# Autodesk Inventor assembly: MM0861AN100_G21_804
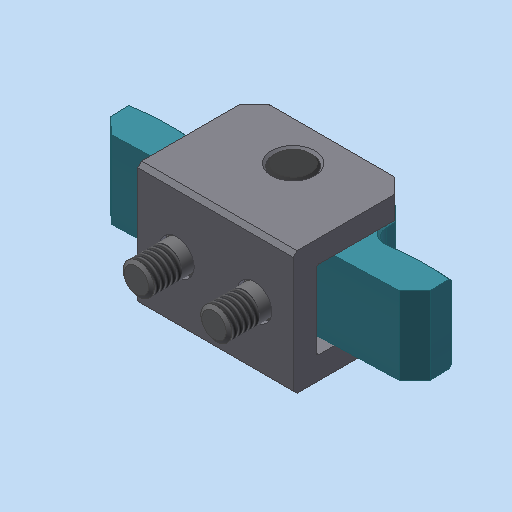
[picture p0: Inventor's stored thumbnail of the model, 512x512]
Saved by Autodesk Inventor 2023.3 (Build 273359000, 359)
## iProperties
Created: 2018-10-31
Part Number: MM0861AN100_G21_804
Document SubType Name: Assembly
Designer: Rose
Mass: 40.103 g
Surface Area: 44.0912 cm^2
Volume: 5.10866 cm^3
Density: 7.85 g/cm^3
AnP_Kommentar_aktuell: =<Comments>
AnP_Material_aktuell: =<Material>
Author: Rose
Revision Number: 01
## Documents named in this file (5)
- C:\Users\rea9an\Documents\Inventor\TCAI2412_te1910_EM\AS00000890.iam
- C:\Users\rea9an\Documents\Inventor\TCAI2412_te1910_EM\PT00004827.ipt
- C:\Users\rea9an\Documents\Inventor\TCAI2412_te1910_EM\PT00004411.ipt
- C:\Users\rea9an\Documents\Inventor\TCAI2412_te1910_EM\PT00004412.ipt
- C:\Users\rea9an\Documents\Inventor\TCAI2412_te1910_EM\PT00004413.ipt
## Components (5 placed, 4 different names)
1. PT00004411:1 — Passend:1, Passend:2, Passend:3, Fluchtend:1, Einfügen:1, Einfügen:2, Winkel:1
2. PT00004412:1 — Passend:1, Passend:2, Winkel:1
3. PT00004413:1 — Passend:3, Fluchtend:1
4. PT00004827:1 — Einfügen:1
5. PT00004827:2 — Einfügen:2
## Relationships (7: Mate 3, Insert 2, Flush 1, Angle 1)
- Passend:1 [Mate] (0.05 mm): PT00004411:1 ↔ PT00004412:1
- Passend:2 [Mate]: PT00004411:1 ↔ PT00004412:1
- Passend:3 [Mate]: PT00004411:1 ↔ PT00004413:1
- Fluchtend:1 [Flush]: PT00004411:1 ↔ PT00004413:1
- Einfügen:1 [Insert] (0.2 mm): PT00004411:1 ↔ PT00004827:1
- Einfügen:2 [Insert] (0.2 mm): PT00004411:1 ↔ PT00004827:2
- Winkel:1 [Angle] (1.8 deg): PT00004411:1 ↔ PT00004412:1
